# Autodesk Inventor assembly: m3-v3
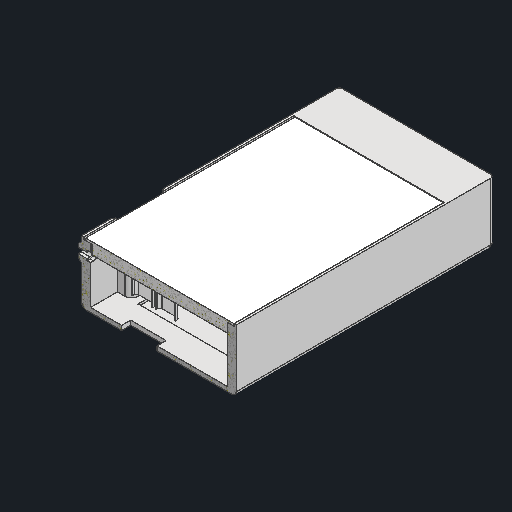
[picture p0: Inventor's stored thumbnail of the model, 512x512]
Saved by Autodesk Inventor 2027 (Build 310192000, 192)
## iProperties
Created: 2026-10-18
Part Number: m3-v3
Document SubType Name: Assembly
Designer: work
Author: work
## Documents named in this file (4)
- C:\Users\khw\Desktop\Mini WebServer\CAD Models\M3_v3\m3-v3.iam
- C:\Users\khw\Desktop\Mini WebServer\CAD Models\M3_v3\m3-v3 case.ipt
- C:\Users\khw\Desktop\Mini WebServer\CAD Models\M3_v3\speaker.ipt
- C:\Users\khw\Desktop\Mini WebServer\CAD Models\M3_v3\jc4880p443.ipt
## Components (3 placed, 3 different names)
1. m3-v3 case:1 — 메이트:1, 메이트:2, 메이트:3, 메이트:4, 메이트:5, 메이트:6
2. speaker:1 — 메이트:1, 메이트:2, 메이트:3
3. jc4880p443:1 — 메이트:4, 메이트:5, 메이트:6
## Relationships (6: Mate 6)
- 메이트:1 [Mate]: m3-v3 case:1 ↔ speaker:1
- 메이트:2 [Mate]: m3-v3 case:1 ↔ speaker:1
- 메이트:3 [Mate]: m3-v3 case:1 ↔ speaker:1
- 메이트:4 [Mate]: m3-v3 case:1 ↔ jc4880p443:1
- 메이트:5 [Mate]: m3-v3 case:1 ↔ jc4880p443:1
- 메이트:6 [Mate]: m3-v3 case:1 ↔ jc4880p443:1
